# Autodesk Inventor assembly: EStop-unit
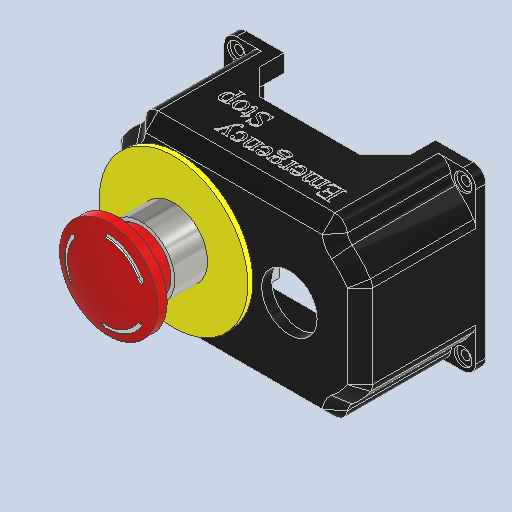
[picture p0: Inventor's stored thumbnail of the model, 512x512]
Saved by Autodesk Inventor 2025.3 (Build 293356030, 356C)
## iProperties
Created: 2025-09-04
Part Number: EStop-unit
Document SubType Name: Assembly
Designer: ibuki_ono
Author: ibuki_ono
## Documents named in this file (3)
- C:\Users\ibuki_ono\Documents\hobby\rogiken\catchrobo\CAD\Hardware_CAD\Inventor\circuit\EStop-unit.iam
- C:\Users\ibuki_ono\Documents\hobby\rogiken\catchrobo\CAD\Hardware_CAD\Inventor\circuit\3D_Estop-fix.ipt
- C:\Users\ibuki_ono\Documents\hobby\rogiken\catchrobo\CAD\Hardware_CAD\Inventor\circuit\EmergencyStop.ipt
## Components (2 placed, 2 different names)
1. 3D_Estop-fix:1 — 挿入:1, 角度:1
2. EmergencyStop:1 — 挿入:1, 角度:1
## Relationships (2: Insert 1, Angle 1)
- 挿入:1 [Insert]: 3D_Estop-fix:1 ↔ EmergencyStop:1
- 角度:1 [Angle] (180 deg): 3D_Estop-fix:1 ↔ EmergencyStop:1
